# Autodesk Inventor assembly: 1133 FP-250x1294x42
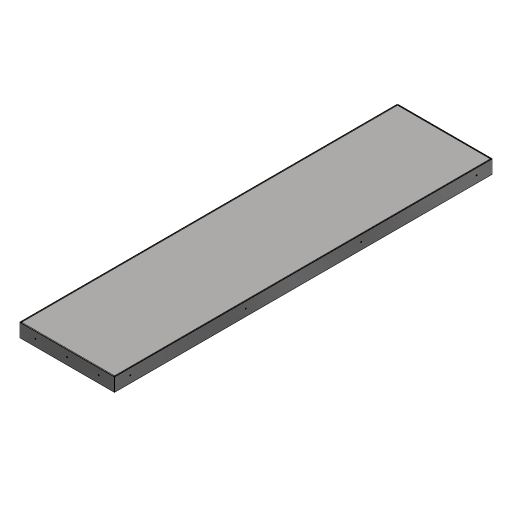
[picture p0: Inventor's stored thumbnail of the model, 512x512]
Saved by Autodesk Inventor 2024.3 (Build 283343000, 343)
## iProperties
RuleStatus: InUse
Created: 2019-06-24
Part Number: 1133 FP-250x1294x42
Material: Generisch
Document SubType Name: Assembly
Designer: MK
Mass: 7951.34 g
Surface Area: 19876 cm^2
Volume: 1114.4 cm^3
Density: 7.13511 g/cm^3
Description: Tür-Paneel
InventorSizerSetup: RP 1T 1
Author: MK
## Documents named in this file (4)
- C:\Users\la\Documents\GitHub\Inventor_Sizer\C# Version\masters\RP\1T\1133 FP-250x1294x42.iam
- C:\Users\la\Documents\GitHub\Inventor_Sizer\C# Version\masters\RP\1T\1133 250x1294x42-Au.ipt
- C:\Users\la\Documents\GitHub\Inventor_Sizer\C# Version\masters\RP\1T\1133 250x1294x42-In.ipt
- C:\Users\la\Documents\GitHub\Inventor_Sizer\C# Version\masters\RP\1T\MFG1000000.ipt
## Components (6 placed, 3 different names)
1. 1133 250x1294x42-Au:1 — Mate:6, Mate:7, Mate:8, Mate:9, Mate:10, Mate:11
2. 1133 250x1294x42-In:1 — Mate:6, Mate:7, Mate:8
3. MFG1000000:1 — Mate:9, Mate:10, Mate:11
4. MFG1000000:2
5. MFG1000000:3
6. MFG1000000:4
## Component patterns: (4 elements, first: MFG1000000:1)
## Relationships (6: Mate 6)
- Mate:6: 1133 250x1294x42-Au:1 ↔ 1133 250x1294x42-In:1
- Mate:7 (0.5 mm): 1133 250x1294x42-Au:1 ↔ 1133 250x1294x42-In:1
- Mate:8 (0.5 mm): 1133 250x1294x42-Au:1 ↔ 1133 250x1294x42-In:1
- Mate:9: 1133 250x1294x42-Au:1 ↔ MFG1000000:1
- Mate:10: 1133 250x1294x42-Au:1 ↔ MFG1000000:1
- Mate:11: 1133 250x1294x42-Au:1 ↔ MFG1000000:1
## Named parameters: Clearance = 0.5 mm, HingeCount = 3, HingePitch = 537 mm, HandleCount = 4, HandlePitch = 298.5 mm, Width = 300 mm, HandlePitchL = 298.5 mm, HandlePitchW = 0 mm, HandleDir = 0, HandleRef = 1194 mm, HandleCountL = 4, HandleCountW = 1, Length = 1194 mm
